# Autodesk Inventor assembly: sensor_commutation_board
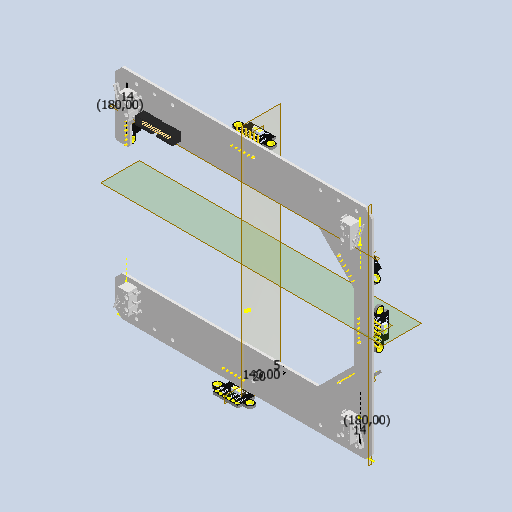
[picture p0: Inventor's stored thumbnail of the model, 512x512]
Saved by Autodesk Inventor 2025 (Build 290162000, 162)
## iProperties
Created: 2026-10-09
Part Number: sensor_commutation_board
Document SubType Name: Assembly
Designer: garin
Author: garin
## Documents named in this file (9)
- C:\Users\Leva\Documents\Git\TheseusV2_Maze\Construction\Theseus_v2\sensor_commutation_board\sensor_commutation_board.iam
- C:\Users\Leva\Documents\Git\TheseusV2_Maze\Construction\Theseus_v2\sensor board.ipt
- C:\Users\Leva\Documents\Git\TheseusV2_Maze\Construction\Theseus_v2\Micro limit switch.ipt
- C:\Users\Leva\Documents\Git\TheseusV2_Maze\Construction\Theseus_v2\Micro limit switch_MIR.ipt
- C:\Users\Leva\Documents\Git\TheseusV2_Maze\Construction\Theseus_v2\sensor_commutation_board\VL53l1X.ipt
- C:\Users\Leva\Documents\Git\TheseusV2_Maze\Construction\Theseus_v2\sensor_commutation_board\PLS-6R-D1.ipt
- C:\Users\Leva\Documents\Git\TheseusV2_Maze\Construction\Theseus_v2\sensor_commutation_board\VL53l1X_MIR2.ipt
- C:\Users\Leva\Documents\Git\TheseusV2_Maze\Construction\Theseus_v2\sensor_commutation_board\PLS-6R-D1_MIR2.ipt
- C:\Users\Leva\Documents\Git\TheseusV2_Maze\Construction\Theseus_v2\mother_board\CONB127P-2R-26W_TH.ipt
## Components (18 placed, 8 different names)
1. sensor board:1 — Совмещение:1, Заподлицо:1, Совмещение:2, Совмещение:3, Заподлицо:2, Совмещение:4, Совмещение:5, Заподлицо:3, Совмещение:6, Совмещение:7, Заподлицо:4, Совмещение:8, Заподлицо:5, Совмещение:10, Угол:1, Совмещение:11, Совмещение:13, Заподлицо:7, Угол:2, Совмещение:14, Совмещение:15, Совмещение:16, Заподлицо:10, Угол:3, Заподлицо:11, Совмещение:19, Заподлицо:12, Угол:4, Совмещение:23, Совмещение:24, Совмещение:25, Совмещение:27, Совмещение:28, Заподлицо:18, Совмещение:29
2. Micro limit switch:1 — Совмещение:3, Заподлицо:2, Совмещение:4
3. Micro limit switch_r:1 — Совмещение:1, Заподлицо:1, Совмещение:2
4. Micro limit switch:2 — Совмещение:7, Заподлицо:4, Совмещение:8
5. Micro limit switch_r:2 — Совмещение:5, Заподлицо:3, Совмещение:6
6. VL53l1X:1 — Заподлицо:5, Угол:1, Совмещение:11, Заподлицо:6, Совмещение:12, Совмещение:13
7. PLS-6R-D1:1 — Совмещение:10, Заподлицо:6, Совмещение:12
8. VL53l1X:2 — Заподлицо:7, Угол:2, Совмещение:14, Совмещение:16, Совмещение:17, Заподлицо:8
9. PLS-6R-D1:2 — Совмещение:15, Совмещение:17, Заподлицо:8
10. VL53l1X:3 — Заподлицо:10, Угол:3, Заподлицо:11, Совмещение:20
11. PLS-6R-D1:3 — Совмещение:19, Совмещение:20, Заподлицо:12
12. VL53l1X:4 — Заподлицо:15, Угол:4, Совмещение:24, Совмещение:25
13. PLS-6R-D1:4 — Заподлицо:15, Совмещение:23
14. VL53l1X_MIR2:1 — Заподлицо:16, Совмещение:26, Заподлицо:17
15. PLS-6R-D1_MIR2:1 — Заподлицо:16, Совмещение:26, Заподлицо:17
16. VL53l1X:5
17. PLS-6R-D1:5 — Совмещение:27
18. CONB127P-2R-26W_TH:1 — Совмещение:28, Заподлицо:18, Совмещение:29
## Relationships (46: Mate 26, Flush 16, Angle 4)
- Совмещение:1 [Mate]: sensor board:1 ↔ Micro limit switch_r:1
- Заподлицо:1 [Flush] (2.6 mm): sensor board:1 ↔ Micro limit switch_r:1
- Совмещение:2 [Mate] (-3 mm): sensor board:1 ↔ Micro limit switch_r:1
- Совмещение:3 [Mate]: sensor board:1 ↔ Micro limit switch:1
- Заподлицо:2 [Flush] (2.6 mm): sensor board:1 ↔ Micro limit switch:1
- Совмещение:4 [Mate] (-3 mm): sensor board:1 ↔ Micro limit switch:1
- Совмещение:5 [Mate]: sensor board:1 ↔ Micro limit switch_r:2
- Заподлицо:3 [Flush] (2.6 mm): sensor board:1 ↔ Micro limit switch_r:2
- Совмещение:6 [Mate] (-3 mm): sensor board:1 ↔ Micro limit switch_r:2
- Совмещение:7 [Mate]: sensor board:1 ↔ Micro limit switch:2
- Заподлицо:4 [Flush] (2.6 mm): sensor board:1 ↔ Micro limit switch:2
- Совмещение:8 [Mate] (-3 mm): sensor board:1 ↔ Micro limit switch:2
- Заподлицо:5 [Flush] (1.6 mm): sensor board:1 ↔ VL53l1X:1
- Совмещение:10 [Mate]: sensor board:1 ↔ PLS-6R-D1:1
- Угол:1 [Angle] (180 deg): sensor board:1 ↔ VL53l1X:1
- Совмещение:11 [Mate]: sensor board:1 ↔ VL53l1X:1
- Заподлицо:6 [Flush]: VL53l1X:1 ↔ PLS-6R-D1:1
- Совмещение:12 [Mate]: VL53l1X:1 ↔ PLS-6R-D1:1
- Совмещение:13 [Mate]: sensor board:1 ↔ VL53l1X:1
- Заподлицо:7 [Flush] (1.6 mm): sensor board:1 ↔ VL53l1X:2
- Угол:2 [Angle] (180 deg): sensor board:1 ↔ VL53l1X:2
- Совмещение:14 [Mate]: sensor board:1 ↔ VL53l1X:2
- Совмещение:15 [Mate]: sensor board:1 ↔ PLS-6R-D1:2
- Совмещение:16 [Mate]: sensor board:1 ↔ VL53l1X:2
- Совмещение:17 [Mate]: VL53l1X:2 ↔ PLS-6R-D1:2
- Заподлицо:8 [Flush]: VL53l1X:2 ↔ PLS-6R-D1:2
- Заподлицо:10 [Flush] (1.6 mm): sensor board:1 ↔ VL53l1X:3
- Угол:3 [Angle] (180 deg): sensor board:1 ↔ VL53l1X:3
- Заподлицо:11 [Flush]: sensor board:1 ↔ VL53l1X:3
- Совмещение:19 [Mate]: sensor board:1 ↔ PLS-6R-D1:3
- Совмещение:20 [Mate]: VL53l1X:3 ↔ PLS-6R-D1:3
- Заподлицо:12 [Flush]: sensor board:1 ↔ PLS-6R-D1:3
- [Flush]: VL53l1X:4 ↔ PLS-6R-D1:4
- [Mate]: VL53l1X:4 ↔ PLS-6R-D1:4
- Заподлицо:15 [Flush]: VL53l1X:4 ↔ PLS-6R-D1:4
- Угол:4 [Angle] (180 deg): sensor board:1 ↔ VL53l1X:4
- Совмещение:23 [Mate]: sensor board:1 ↔ PLS-6R-D1:4
- Совмещение:24 [Mate] (-2.5 mm): sensor board:1 ↔ VL53l1X:4
- Совмещение:25 [Mate] (-2.5 mm): sensor board:1 ↔ VL53l1X:4
- Заподлицо:16 [Flush]: VL53l1X_MIR2:1 ↔ PLS-6R-D1_MIR2:1
- Совмещение:26 [Mate]: VL53l1X_MIR2:1 ↔ PLS-6R-D1_MIR2:1
- Заподлицо:17 [Flush]: VL53l1X_MIR2:1 ↔ PLS-6R-D1_MIR2:1
- Совмещение:27 [Mate]: sensor board:1 ↔ PLS-6R-D1:5
- Совмещение:28 [Mate] (8.596 mm): sensor board:1 ↔ CONB127P-2R-26W_TH:1
- Заподлицо:18 [Flush] (3 mm): sensor board:1 ↔ CONB127P-2R-26W_TH:1
- Совмещение:29 [Mate]: sensor board:1 ↔ CONB127P-2R-26W_TH:1
## Named parameters: d43_d18 = 0 mm, d44_d19 = 0 mm
